# Autodesk Inventor assembly: 3-3
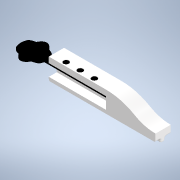
[picture p0: Inventor's stored thumbnail of the model, 180x180]
Saved by Autodesk Inventor 2020 (Build 240168000, 168)
## iProperties
Created: 2022-06-23
Part Number: 3-3
Document SubType Name: Assembly
Designer: drago
Author: drago
## Documents named in this file (3)
- C:\Users\drago\Documents\ULTIMA_VARIANTA\chei\3-3.iam
- C:\Users\drago\Documents\ULTIMA_VARIANTA\Broasca\Broascav3\P2_V3_001.ipt
- C:\Users\drago\Documents\ULTIMA_VARIANTA\chei\cheie_v3_corect.ipt
## Components (2 placed, 2 different names)
1. P2_V3_001:1 — Mate:1, Mate:2, Mate:3, Mate:4
2. cheie_v3_corect:1 — Mate:1, Mate:2, Mate:3, Mate:4
## Relationships (4: Mate 4)
- Mate:1: P2_V3_001:1 ↔ cheie_v3_corect:1
- Mate:2: P2_V3_001:1 ↔ cheie_v3_corect:1
- Mate:3: P2_V3_001:1 ↔ cheie_v3_corect:1
- Mate:4: P2_V3_001:1 ↔ cheie_v3_corect:1
